# Autodesk Inventor assembly: senior 1
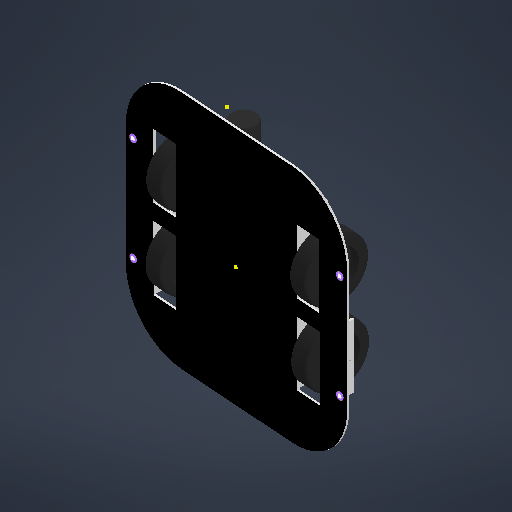
[picture p0: Inventor's stored thumbnail of the model, 512x512]
Saved by Autodesk Inventor 2025.2 (Build 292293000, 293)
## iProperties
Created: 2024-12-25
Part Number: senior 1
Document SubType Name: Assembly
Designer: user
Author: user
## Documents named in this file (12)
- C:\Users\user\OneDrive\Senior\senior 1.iam
- C:\Users\user\OneDrive\Senior\motor 1.ipt
- C:\Users\user\OneDrive\Senior\plate.ipt
- C:\Users\user\OneDrive\Senior\wheel.ipt
- C:\Users\user\OneDrive\Senior\wheel support.ipt
- C:\Users\user\OneDrive\Senior\wheel support_MIR1.ipt
- C:\Users\user\OneDrive\Senior\wheel_MIR.ipt
- C:\Users\user\OneDrive\Senior\washer.ipt
- C:\Users\user\OneDrive\Senior\bolt.ipt
- C:\Users\user\OneDrive\Senior\washer_MIR.ipt
- C:\Users\user\OneDrive\Senior\bolt_MIR.ipt
- C:\Users\user\OneDrive\Senior\motor support1.ipt
## Components (17 placed, 11 different names)
1. motor 1:1 — Mate:1, Rotational:1, Tangent:1, Mate:13, Mate:14, Mate:15
2. plate:1 — Mate:3, Tangent:1, Tangent:2, Mate:4, Slider:2, Angle:1, Tangent:3, Angle:2, Tangent:4, Mate:8, Mate:12, Mate:18
3. wheel:1 — Mate:1, Rotational:1, Mate:3, Mate:19
4. motor 1:2 — Tangent:2, Mate:16, Mate:17
5. wheel:2 — Mate:4, Mate:19
6. wheel support:1 — Slider:2, Mate:7, Mate:9, Rotational:3
7. wheel support:4 — Mate:7, Mate:8, Mate:9, Rigid:1
8. wheel:3 — Rotational:3, Rotational:4
9. wheel support_MIR1:1 — Mate:10, Mate:11
10. wheel support_MIR1:2 — Mate:10, Mate:11
11. wheel_MIR:1
12. washer:1 — Rotational:4
13. bolt:1 — Rigid:1
14. washer_MIR:1
15. bolt_MIR:1
16. motor support1:1 — Mate:12, Mate:13, Mate:14, Mate:15
17. motor support1:2 — Mate:16, Mate:17, Mate:18
## Relationships (30: Mate 17, RevoluteJoint 4, Tangent 4, Angle 2, TranslationJoint 1, Symmetry 1, WeldJoint 1)
- Mate:1: motor 1:1 ↔ wheel:1
- Rotational:1 [RevoluteJoint]: motor 1:1 ↔ wheel:1
- [Mate]: motor 1:2 ↔ wheel:2
- [RevoluteJoint]: motor 1:2 ↔ wheel:2
- Mate:3 (7.5 mm): plate:1 ↔ wheel:1
- Tangent:1: motor 1:1 ↔ plate:1
- Tangent:2: plate:1 ↔ motor 1:2
- Mate:4 (7.5 mm): plate:1 ↔ wheel:2
- Slider:2 [TranslationJoint]: plate:1 ↔ wheel support:1
- Angle:1 (0 deg): plate:1
- Tangent:3: plate:1
- Angle:2 (0 deg): plate:1
- Tangent:4: plate:1
- Symmetry:1
- Mate:7: wheel support:1 ↔ wheel support:4
- Mate:8: plate:1 ↔ wheel support:4
- Mate:9 (60 mm): wheel support:1 ↔ wheel support:4
- Mate:10 (70 mm): wheel support_MIR1:1 ↔ wheel support_MIR1:2
- Mate:11: wheel support_MIR1:1 ↔ wheel support_MIR1:2
- Rotational:3 [RevoluteJoint] (-22.5 mm): wheel support:1 ↔ wheel:3
- Rigid:1 [WeldJoint]: wheel support:4 ↔ bolt:1
- Rotational:4 [RevoluteJoint]: wheel:3 ↔ washer:1
- Mate:12: plate:1 ↔ motor support1:1
- Mate:13: motor 1:1 ↔ motor support1:1
- Mate:14: motor 1:1 ↔ motor support1:1
- Mate:15: motor 1:1 ↔ motor support1:1
- Mate:16: motor 1:2 ↔ motor support1:2
- Mate:17: motor 1:2 ↔ motor support1:2
- Mate:18: plate:1 ↔ motor support1:2
- Mate:19: wheel:1 ↔ wheel:2
## Named parameters: d3_d0 = 0 mm, d4_d1 = 0 mm, d5_d2 = 142.928627 deg
